# Autodesk Inventor assembly: Assembly1
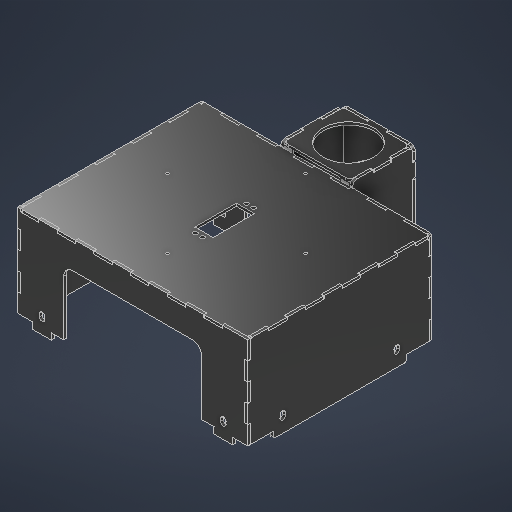
[picture p0: Inventor's stored thumbnail of the model, 512x512]
Saved by Autodesk Inventor 2027.1 (Build 311270010, 270A)
## iProperties
Created: 2026-10-07
Part Number: Assembly1
Document SubType Name: Assembly
Designer: daniel
Author: daniel
## Documents named in this file (13)
- C:\Users\Ahmed\Desktop\Fall 26\Design 1 Repo\MCT333_Design_of_Mechatronics_Systems_1\CAD\FEED and Sorting\box\MagazineBox.iam
- C:\Users\Ahmed\Desktop\Fall 26\Design 1 Repo\MCT333_Design_of_Mechatronics_Systems_1\CAD\FEED and Sorting\box\MagazineBoxCeiling.ipt
- C:\Users\Ahmed\Desktop\Fall 26\Design 1 Repo\MCT333_Design_of_Mechatronics_Systems_1\CAD\FEED and Sorting\box\MagazineBoxSide.ipt
- C:\Users\Ahmed\Desktop\Fall 26\Design 1 Repo\MCT333_Design_of_Mechatronics_Systems_1\CAD\FEED and Sorting\box\MagazineBoxFace.ipt
- C:\Users\Ahmed\Desktop\Fall 26\Design 1 Repo\MCT333_Design_of_Mechatronics_Systems_1\CAD\FEED and Sorting\box\MagazineBoxBack.ipt
- C:\Users\Ahmed\Desktop\Fall 26\Design 1 Repo\MCT333_Design_of_Mechatronics_Systems_1\CAD\FEED and Sorting\box\SlotSide.ipt
- C:\Users\Ahmed\Desktop\Fall 26\Design 1 Repo\MCT333_Design_of_Mechatronics_Systems_1\CAD\FEED and Sorting\box\SlotBack.ipt
- C:\Users\Ahmed\Desktop\Fall 26\Design 1 Repo\MCT333_Design_of_Mechatronics_Systems_1\CAD\FEED and Sorting\box\SlotCeiling.ipt
- C:\Users\Ahmed\Desktop\Fall 26\Design 1 Repo\MCT333_Design_of_Mechatronics_Systems_1\CAD\FEED and Sorting\box\Corner milestone 1.ipt
- C:\Users\Ahmed\Documents\Inventor\Content Center Files\R2027\en-US\ISO 7049 - C-Z(1)\DIN EN ISO 7049 - ST2.2 x 4.5 - C - Z.ipt
- C:\Users\Ahmed\Desktop\Fall 26\Design 1 Repo\MCT333_Design_of_Mechatronics_Systems_1\CAD\FEED and Sorting\box\Corner milestone 1_MIR.ipt
- C:\Users\Ahmed\Desktop\Fall 26\Design 1 Repo\MCT333_Design_of_Mechatronics_Systems_1\CAD\FEED and Sorting\box\Corner milestone 1_MIR1.ipt
- C:\Users\Ahmed\Desktop\Fall 26\Design 1 Repo\MCT333_Design_of_Mechatronics_Systems_1\CAD\FEED and Sorting\box\Corner milestone 1_MIR_MIR.ipt
## Components (25 placed, 11 different names)
1. MagazineBoxBack:1 — Flush:1, Flush:2, Flush:3, Mate:12, Flush:4, Flush:5, Flush:6, Flush:7, Flush:9, Flush:10, Flush:11, Symmetry:2
2. MagazineBoxSide:1 — Flush:9, Flush:10, Flush:11, Symmetry:1
3. MagazineBoxSide:2 — Flush:1, Flush:7, Flush:8, Flush:12, Flush:14, Symmetry:1
4. MagazineBoxCeiling:1 — Flush:2, Flush:3, Flush:6, Flush:8, Flush:13
5. MagazineBoxBack:2 — Flush:12, Flush:13, Flush:14, Mate:16, Mate:17, Mate:18, Mate:22, Symmetry:2, Symmetry:4
6. SlotSide:1 — Mate:16, Mate:17, Flush:20, Flush:15, Flush:16, Flush:21, Mate:23, Symmetry:3
7. SlotSide:2 — Mate:18, Mate:20, Mate:21, Mate:22, Mate:25, Symmetry:3
8. SlotBack:1 — Flush:20, Flush:15, Flush:16, Mate:20, Mate:21, Flush:22, Mate:24, Symmetry:4
9. SlotCeiling:1 — Flush:21, Flush:22, Mate:23, Mate:26
10. Corner milestone 1:1 — Mate:24, Mate:25, Mate:26, Insert:1, Insert:2, Insert:3
11. DIN EN ISO 7049 - C-Z ST2.2 x 4.5 - C - Z:1 — Insert:1
12. DIN EN ISO 7049 - C-Z ST2.2 x 4.5 - C - Z:2 — Insert:2
13. DIN EN ISO 7049 - C-Z ST2.2 x 4.5 - C - Z:3 — Insert:3
14. Corner milestone 1_MIR:1 — Insert:4, Insert:5, Insert:6
15. DIN EN ISO 7049 - C-Z ST2.2 x 4.5 - C - Z:4 — Insert:4
16. DIN EN ISO 7049 - C-Z ST2.2 x 4.5 - C - Z:5 — Insert:5
17. DIN EN ISO 7049 - C-Z ST2.2 x 4.5 - C - Z:6 — Insert:6
18. Corner milestone 1_MIR1:1 — Insert:7, Insert:8, Insert:9
19. DIN EN ISO 7049 - C-Z ST2.2 x 4.5 - C - Z:7 — Insert:7
20. DIN EN ISO 7049 - C-Z ST2.2 x 4.5 - C - Z:8 — Insert:8
21. DIN EN ISO 7049 - C-Z ST2.2 x 4.5 - C - Z:9 — Insert:9
22. Corner milestone 1_MIR_MIR:1 — Insert:10, Insert:11, Insert:12
23. DIN EN ISO 7049 - C-Z ST2.2 x 4.5 - C - Z:10 — Insert:10
24. DIN EN ISO 7049 - C-Z ST2.2 x 4.5 - C - Z:11 — Insert:11
25. DIN EN ISO 7049 - C-Z ST2.2 x 4.5 - C - Z:12 — Insert:12
## Relationships (47: Flush 19, Mate 12, Insert 12, Symmetry 4)
- [Mate]: MagazineBoxSide:1 ↔ MagazineBoxCeiling:1
- Flush:1: MagazineBoxBack:1 ↔ MagazineBoxSide:2
- Flush:2: MagazineBoxBack:1 ↔ MagazineBoxCeiling:1
- Flush:3: MagazineBoxBack:1 ↔ MagazineBoxCeiling:1
- Mate:12: MagazineBoxBack:1
- Flush:4: MagazineBoxBack:1
- Flush:5: MagazineBoxBack:1
- Flush:6: MagazineBoxBack:1 ↔ MagazineBoxCeiling:1
- Flush:7: MagazineBoxBack:1 ↔ MagazineBoxSide:2
- Flush:8: MagazineBoxSide:2 ↔ MagazineBoxCeiling:1
- Flush:9: MagazineBoxBack:1 ↔ MagazineBoxSide:1
- Flush:10: MagazineBoxBack:1 ↔ MagazineBoxSide:1
- Flush:11: MagazineBoxBack:1 ↔ MagazineBoxSide:1
- Flush:12: MagazineBoxSide:2 ↔ MagazineBoxBack:2
- Flush:13: MagazineBoxCeiling:1 ↔ MagazineBoxBack:2
- Flush:14: MagazineBoxSide:2 ↔ MagazineBoxBack:2
- Mate:16: MagazineBoxBack:2 ↔ SlotSide:1
- Mate:17: MagazineBoxBack:2 ↔ SlotSide:1
- Flush:20: SlotSide:1 ↔ SlotBack:1
- Flush:15: SlotSide:1 ↔ SlotBack:1
- Flush:16: SlotSide:1 ↔ SlotBack:1
- Mate:18: MagazineBoxBack:2 ↔ SlotSide:2
- Mate:20: SlotSide:2 ↔ SlotBack:1
- Mate:21: SlotSide:2 ↔ SlotBack:1
- Mate:22: MagazineBoxBack:2 ↔ SlotSide:2
- Flush:21: SlotSide:1 ↔ SlotCeiling:1
- Flush:22: SlotBack:1 ↔ SlotCeiling:1
- Mate:23: SlotSide:1 ↔ SlotCeiling:1
- Symmetry:1: MagazineBoxSide:1 ↔ MagazineBoxSide:2
- Symmetry:2: MagazineBoxBack:1 ↔ MagazineBoxBack:2
- Mate:24: SlotBack:1 ↔ Corner milestone 1:1
- Mate:25: SlotSide:2 ↔ Corner milestone 1:1
- Mate:26: SlotCeiling:1 ↔ Corner milestone 1:1
- Insert:1: Corner milestone 1:1 ↔ DIN EN ISO 7049 - C-Z ST2.2 x 4.5 - C - Z:1
- Insert:2: Corner milestone 1:1 ↔ DIN EN ISO 7049 - C-Z ST2.2 x 4.5 - C - Z:2
- Insert:3: Corner milestone 1:1 ↔ DIN EN ISO 7049 - C-Z ST2.2 x 4.5 - C - Z:3
- Symmetry:3: SlotSide:1 ↔ SlotSide:2
- Symmetry:4: MagazineBoxBack:2 ↔ SlotBack:1
- Insert:4: Corner milestone 1_MIR:1 ↔ DIN EN ISO 7049 - C-Z ST2.2 x 4.5 - C - Z:4
- Insert:5: Corner milestone 1_MIR:1 ↔ DIN EN ISO 7049 - C-Z ST2.2 x 4.5 - C - Z:5
- Insert:6: Corner milestone 1_MIR:1 ↔ DIN EN ISO 7049 - C-Z ST2.2 x 4.5 - C - Z:6
- Insert:7: Corner milestone 1_MIR1:1 ↔ DIN EN ISO 7049 - C-Z ST2.2 x 4.5 - C - Z:7
- Insert:8: Corner milestone 1_MIR1:1 ↔ DIN EN ISO 7049 - C-Z ST2.2 x 4.5 - C - Z:8
- Insert:9: Corner milestone 1_MIR1:1 ↔ DIN EN ISO 7049 - C-Z ST2.2 x 4.5 - C - Z:9
- Insert:10: Corner milestone 1_MIR_MIR:1 ↔ DIN EN ISO 7049 - C-Z ST2.2 x 4.5 - C - Z:10
- Insert:11: Corner milestone 1_MIR_MIR:1 ↔ DIN EN ISO 7049 - C-Z ST2.2 x 4.5 - C - Z:11
- Insert:12: Corner milestone 1_MIR_MIR:1 ↔ DIN EN ISO 7049 - C-Z ST2.2 x 4.5 - C - Z:12
